# Autodesk Inventor assembly: pattern-formula
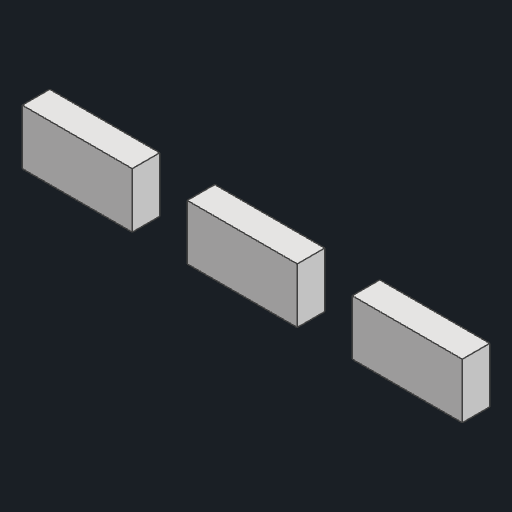
[picture p0: Inventor's stored thumbnail of the model, 512x512]
Saved by Autodesk Inventor 2026.1 (Build 301233000, 233)
## iProperties
Created: 2026-10-30
Part Number: pattern-formula
Document SubType Name: Assembly
Designer: anony
Author: anony
## Documents named in this file (2)
- C:\Users\anony\OneDrive\Desktop\AI Projects\CAD Convert\corpus\generated\asm\pattern-formula.iam
- C:\Users\anony\OneDrive\Desktop\AI Projects\CAD Convert\corpus\generated\asmparts\box.ipt
## Components (3 placed, 1 different names)
1. box:1
2. box:2
3. box:3
## Component patterns: (3 elements, first: box:1)
